# Autodesk Inventor assembly: ZSB_210324
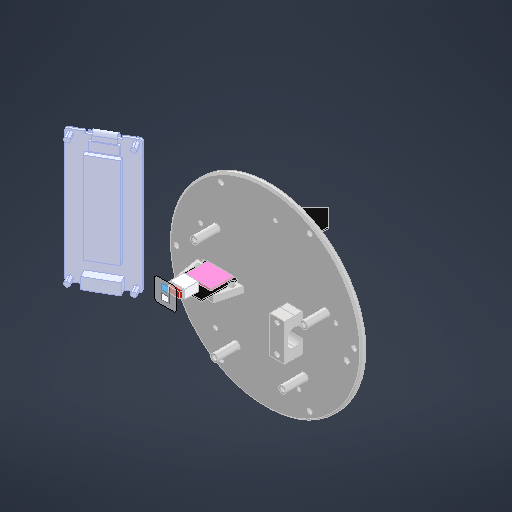
[picture p0: Inventor's stored thumbnail of the model, 512x512]
Saved by Autodesk Inventor 2027 (Build 310192000, 192)
## iProperties
Created: 2021-03-24
Part Number: ZSB_210324
Document SubType Name: Assembly
Designer: uhlma
Author: uhlma
## Documents named in this file (9)
- E:\self_watering_pot\3D\Plant_pot\files\Assembly_Flaura.iam
- E:\self_watering_pot\3D\Plant_pot\files\Dummy_Capacitive_Soil_Sensor.ipt
- E:\self_watering_pot\3D\Plant_pot\files\Water_Level_Sensor_Mount.ipt
- E:\self_watering_pot\3D\Plant_pot\files\Housing_Bottom.ipt
- E:\self_watering_pot\3D\Plant_pot\files\Housing_Inner_Outer.ipt
- E:\self_watering_pot\3D\Plant_pot\files\2.9inch e-Paper Module bw v2\2.9inch e-Paper Module bw v2.ipt
- E:\self_watering_pot\3D\Plant_pot\files\Bottom_plate.ipt
- E:\self_watering_pot\pcb\main_board\main_board\main_board.ipt
- E:\self_watering_pot\3D\Plant_pot\files\pump_mount.ipt
## Components (8 placed, 8 different names)
1. Housing_Inner_Outer:1 — Passend:1, Flush:33, Cylindrical:5, Cylindrical:6
2. Housing_Bottom:1 — Passend:1, Passend:2, Passend:3, Passend:36, Passend:37, Winkel:5, Einfügen:10, Mate:48, Mate:49, Mate:54, Cylindrical:3, Cylindrical:4, Rotational:1, Rotational:2
3. Dummy_Capacitive_Soil_Sensor:1 — Mate:48, Mate:49
4. Water_Level_Sensor_Mount:1 — Einfügen:10
5. 2.9inch e-Paper Module bw v2:1 — Cylindrical:5, Cylindrical:6
6. Bottom_plate:1 — Flush:33
7. main_board:1 — Mate:54, Cylindrical:3, Cylindrical:4
8. pump_mount:1 — Rotational:1, Rotational:2
## Relationships (18: Mate 8, CylindricalJoint 4, Flush 2, RevoluteJoint 2, Angle 1, Insert 1)
- Passend:1 [Mate]: Housing_Inner_Outer:1 ↔ Housing_Bottom:1
- Passend:2 [Mate]: Housing_Bottom:1
- Passend:3 [Mate]: Housing_Bottom:1
- Fluchtend:32 [Flush]
- Passend:36 [Mate]: Housing_Bottom:1
- Passend:37 [Mate]: Housing_Bottom:1
- Winkel:5 [Angle] (0 deg): Housing_Bottom:1
- Einfügen:10 [Insert]: Housing_Bottom:1 ↔ Water_Level_Sensor_Mount:1
- Mate:48: Housing_Bottom:1 ↔ Dummy_Capacitive_Soil_Sensor:1
- Mate:49: Housing_Bottom:1 ↔ Dummy_Capacitive_Soil_Sensor:1
- Flush:33: Housing_Inner_Outer:1 ↔ Bottom_plate:1
- Mate:54: Housing_Bottom:1 ↔ main_board:1
- Cylindrical:3: Housing_Bottom:1 ↔ main_board:1
- Cylindrical:4: Housing_Bottom:1 ↔ main_board:1
- Cylindrical:5: Housing_Inner_Outer:1 ↔ 2.9inch e-Paper Module bw v2:1
- Cylindrical:6: Housing_Inner_Outer:1 ↔ 2.9inch e-Paper Module bw v2:1
- Rotational:1 [RevoluteJoint]: Housing_Bottom:1 ↔ pump_mount:1
- Rotational:2 [RevoluteJoint]: Housing_Bottom:1 ↔ pump_mount:1
